# Autodesk Inventor assembly: MM0948AN130_G10_801
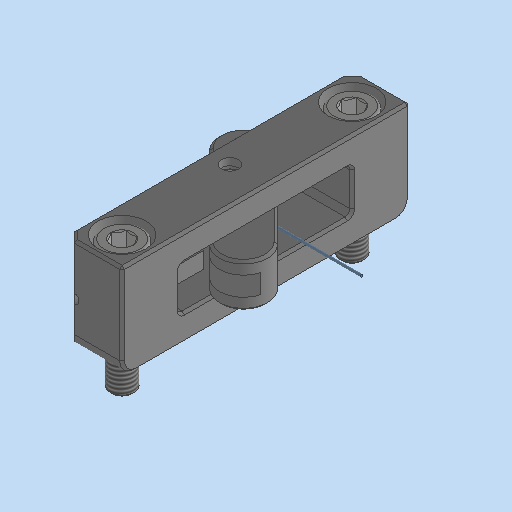
[picture p0: Inventor's stored thumbnail of the model, 512x512]
Saved by Autodesk Inventor 2023.3 (Build 273359000, 359)
## iProperties
RuleStatus: InUse
Created: 2023-03-23
Part Number: MM0948AN130_G10_801
Description: =<RBPARTNOTITLE2>
Document SubType Name: Assembly
Designer: FH/Wi
Mass: 98.5625 g
Surface Area: 89.3398 cm^2
Volume: 12.5729 cm^3
Density: 7.83931 g/cm^3
AnP_Kategorie: 98
AnP_Material: =<Material>
AnP_TemplVers: 20200821
RBDOCUMENTTYPE: DRF
RBDOCUMENTVERSION: 00
RBDRAWINGMAINSCALE: 1:1
RBDRAWINGMISSINGSPEC: --
RBDRAWINGVOLUME: --
RBDSV1: 0850
RBGBEDGESIN1: +0,5
RBGBEDGESIN2: +0,2
RBGBEDGESOUT1: -0,3
RBGBEDGESOUT2: -0,1
RBMATERIAL: =<Material>
RBMATMEETS: --
RBMATNO: =<Part Number>
RBPARTMADEOF: --
RBPARTNO: SIEHE MNR
RBPARTNOTITLE1: enter description here
RBPARTNOTITLE2: hier Bezeichnung eintragen
RBPARTSAFETYINDICATOR: --
RBSURFACE: --
RBSURFACE2: --
RBZEDGESNORM: ISO13715:2002-06
RBZGENDIMCLASS: m
RBZGENDIMNORM: ISO 2768-1:1989-11
RBZGENGEOCLASS: H
RBZGENGEONORM: ISO 2768-2:1989-11
RBZSURFACENORM: ISO13D2:2002-02
RBZTOLERANCENORM: ISO 14405-1:2010-12
Author: FH/Wi
Keywords: =<RBPARTMADEOF>
Comments: =<RBSURFACE2>
Revision Number: 01
## Documents named in this file (6)
- C:\Users\rea9an\Documents\Inventor\TCAI2412_te1910_EM\AS00000947.iam
- C:\Users\rea9an\Documents\Inventor\TCAI2412_te1910_EM\PT00004645.ipt
- C:\Users\rea9an\Documents\Inventor\TCAI2412_te1910_EM\PT00004646.ipt
- C:\Users\rea9an\Documents\Inventor\TCAI2412_te1910_EM\PT00004654.ipt
- C:\Users\rea9an\Documents\Inventor\TCAI2412_te1910_EM\PT00004881.ipt
- C:\Users\rea9an\Documents\Inventor\TCAI2412_te1910_EM\PT00004915.ipt
## Components (6 placed, 5 different names)
1. PT00004645:1 — Winkel:1, Passend:2, Passend:4
2. PT00004646:1 — Winkel:1, Passend:3, Passend:4
3. PT00004881:2
4. PT00004881:1
5. PT00004915:1 — Passend:3
6. PT00004654:1 — Passend:2
## Relationships (8: Mate 4, Insert 3, Angle 1)
- [Mate]: PT00004915:1 ↔ PT00004654:1
- Winkel:1 [Angle] (-45 deg): PT00004645:1 ↔ PT00004646:1
- [Insert]: PT00004645:1 ↔ PT00004881:1
- [Insert]: PT00004645:1 ↔ PT00004881:2
- [Insert]: PT00004645:1 ↔ PT00004915:1
- Passend:2 [Mate]: PT00004645:1 ↔ PT00004654:1
- Passend:3 [Mate]: PT00004646:1 ↔ PT00004915:1
- Passend:4 [Mate]: PT00004645:1 ↔ PT00004646:1
